# Autodesk Inventor assembly: 扭力装配体_2
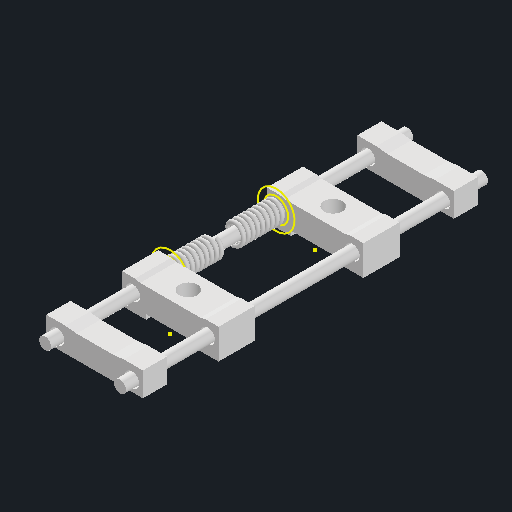
[picture p0: Inventor's stored thumbnail of the model, 512x512]
Saved by Autodesk Inventor 2025 (Build 290162000, 162)
## iProperties
Created: 2025-08-27
Part Number: 扭力装配体_2
Document SubType Name: Assembly
Designer: HZD
Author: HZD
## Documents named in this file (5)
- D:\2 B Mechanical design\有光\铰链\扭力装配体_2.iam
- D:\2 B Mechanical design\有光\铰链\轴0.5_2.ipt
- D:\2 B Mechanical design\有光\铰链\扭力模块结构_2.ipt
- D:\2 B Mechanical design\有光\铰链\扭簧_2.ipt
- D:\2 B Mechanical design\有光\铰链\扭力模块结构挡板_2.ipt
## Components (8 placed, 4 different names)
1. 轴0.5_2:1 — 配合:2, 表面齐平:5, 配合:6, 配合:18, 配合:20
2. 扭力模块结构_2:1 — 配合:2, 配合:7
3. 轴0.5_2:2 — 配合:7, 表面齐平:5, 配合:3, 配合:8, 配合:17, 配合:19, 配合:21
4. 扭力模块结构_2:2 — 配合:6, 配合:3
5. 扭簧_2:1 — 配合:8
6. 扭力模块结构挡板_2:1 — 配合:18, 配合:17
7. 扭力模块结构挡板_2:2 — 配合:20, 配合:19
8. 扭簧_2:2 — 配合:21
## Relationships (11: Mate 10, Flush 1)
- 配合:2 [Mate]: 轴0.5_2:1 ↔ 扭力模块结构_2:1
- 配合:7 [Mate]: 扭力模块结构_2:1 ↔ 轴0.5_2:2
- 表面齐平:5 [Flush]: 轴0.5_2:1 ↔ 轴0.5_2:2
- 配合:6 [Mate]: 轴0.5_2:1 ↔ 扭力模块结构_2:2
- 配合:3 [Mate]: 轴0.5_2:2 ↔ 扭力模块结构_2:2
- 配合:8 [Mate]: 轴0.5_2:2 ↔ 扭簧_2:1
- 配合:18 [Mate]: 轴0.5_2:1 ↔ 扭力模块结构挡板_2:1
- 配合:17 [Mate]: 轴0.5_2:2 ↔ 扭力模块结构挡板_2:1
- 配合:20 [Mate]: 轴0.5_2:1 ↔ 扭力模块结构挡板_2:2
- 配合:19 [Mate]: 轴0.5_2:2 ↔ 扭力模块结构挡板_2:2
- 配合:21 [Mate]: 轴0.5_2:2 ↔ 扭簧_2:2
